# Autodesk Inventor assembly: Rotorschutz_Sandläufer
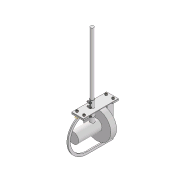
[picture p0: Inventor's stored thumbnail of the model, 180x180]
Saved by Autodesk Inventor 2020.1 (Build 241239000, 239)
## iProperties
Created: 2020-08-20
Part Number: Rotorschutz_Sandläufer
Document SubType Name: Assembly
Designer: s5chfeis
Author: s5chfeis
## Documents named in this file (11)
- Z:\Masterarbeit\CAD\CAD\Rotorschutz_Sandläufer.iam
- Z:\Masterarbeit\CAD\CAD\Motor_Dummy.ipt
- Z:\Masterarbeit\CAD\CAD\Rotorschutz_SL_BT2.ipt
- d:\Users\s5chfeis\Documents\Inventor\Content Center Files\R2020\de-DE\BS 4168(8)\BS 4168 - M10 x 30(7).ipt
- d:\Users\s5chfeis\Documents\Inventor\Content Center Files\R2020\de-DE\AS 1237 (2.1)\AS 1237 - 10.ipt
- d:\Users\s5chfeis\Documents\Inventor\Content Center Files\R2020\de-DE\AS 1112 (2)\AS 1112 - M10  Typ 8.ipt
- d:\Users\s5chfeis\Documents\Inventor\Content Center Files\R2020\de-DE\AS 1420\AS 1420 - 1973 - M8 x 25.ipt
- d:\Users\s5chfeis\Documents\Inventor\Content Center Files\R2020\de-DE\AS 1237 (2.1)\AS 1237 - 8.ipt
- d:\Users\s5chfeis\Documents\Inventor\Content Center Files\R2020\de-DE\AS 1112 (2)\AS 1112 - M8  Typ 8.ipt
- Z:\Masterarbeit\CAD\CAD\Huelse_2_komplett.iam
- Z:\Masterarbeit\CAD\CAD\Rotorschutz_Sandläufer_BG1.iam
## Components (33 placed, 10 different names)
1. Motor_Dummy:1 — Passend:1, Passend:2, Passend:3, Passend:6, Passend:38, Passend:40
2. Rotorschutz_SL_BT2:1 — Passend:6, Einfügen:1, Einfügen:2, Einfügen:3, Einfügen:4, Passend:39, Passend:41, Passend:42
3. BS 4168 : Teil 8 Senkkopf- und Halbrundschrauben mit Innensechskant - metrische Ausführung - Metrisch M10 x 30:1 — Passend:43
4. BS 4168 : Teil 8 Senkkopf- und Halbrundschrauben mit Innensechskant - metrische Ausführung - Metrisch M10 x 30:2
5. BS 4168 : Teil 8 Senkkopf- und Halbrundschrauben mit Innensechskant - metrische Ausführung - Metrisch M10 x 30:3 — Passend:16
6. BS 4168 : Teil 8 Senkkopf- und Halbrundschrauben mit Innensechskant - metrische Ausführung - Metrisch M10 x 30:4 — Passend:18
7. AS 1237 (2.1) 10:1 — Einfügen:1, Einfügen:6
8. AS 1237 (2.1) 10:2 — Einfügen:2, Einfügen:7
9. AS 1237 (2.1) 10:3 — Einfügen:3, Passend:19
10. AS 1237 (2.1) 10:4 — Einfügen:4, Passend:17
11. AS 1112 (2) - Metrisch M10  Typ 8:1 — Einfügen:6
12. AS 1112 (2) - Metrisch M10  Typ 8:2 — Einfügen:7
13. AS 1112 (2) - Metrisch M10  Typ 8:3 — Passend:16, Passend:17
14. AS 1112 (2) - Metrisch M10  Typ 8:4 — Passend:18, Passend:19
15. AS 1237 (2.1) 8:1 — Passend:31
16. AS 1237 (2.1) 8:3 — Passend:33
17. AS 1237 (2.1) 8:4 — Passend:35
18. AS 1237 (2.1) 8:5 — Passend:37
19. AS 1112 (2) - Metrisch M8  Typ 8:1 — Passend:31
20. AS 1112 (2) - Metrisch M8  Typ 8:2 — Passend:33
21. AS 1112 (2) - Metrisch M8  Typ 8:3 — Passend:35
22. AS 1112 (2) - Metrisch M8  Typ 8:4 — Passend:37
23. AS 1237 (2.1) 8:6 — Einfügen:8
24. AS 1237 (2.1) 8:7 — Einfügen:9
25. AS 1237 (2.1) 8:8 — Einfügen:10
26. AS 1237 (2.1) 8:9 — Einfügen:11
27. AS 1420 - Metrisch M8 x 25:1 — Einfügen:8
28. AS 1420 - Metrisch M8 x 25:2 — Einfügen:9
29. AS 1420 - Metrisch M8 x 25:3 — Einfügen:10
30. AS 1420 - Metrisch M8 x 25:4 — Einfügen:11
31. Huelse_2_komplett:1 [sub-assembly] — Passend:38, Passend:39
32. Huelse_2_komplett:2 [sub-assembly] — Passend:40, Passend:41
33. Rotorschutz_Sandläufer_BG1:1 [sub-assembly] — Passend:42, Passend:43
## Relationships (28: Mate 18, Insert 10)
- Passend:1 [Mate]: Motor_Dummy:1
- Passend:2 [Mate]: Motor_Dummy:1
- Passend:3 [Mate]: Motor_Dummy:1
- Passend:6 [Mate]: Motor_Dummy:1 ↔ Rotorschutz_SL_BT2:1
- Einfügen:1 [Insert]: Rotorschutz_SL_BT2:1 ↔ AS 1237 (2.1) 10:1
- Einfügen:2 [Insert]: Rotorschutz_SL_BT2:1 ↔ AS 1237 (2.1) 10:2
- Einfügen:3 [Insert]: Rotorschutz_SL_BT2:1 ↔ AS 1237 (2.1) 10:3
- Einfügen:4 [Insert]: Rotorschutz_SL_BT2:1 ↔ AS 1237 (2.1) 10:4
- Einfügen:6 [Insert]: AS 1237 (2.1) 10:1 ↔ AS 1112 (2) - Metrisch M10  Typ 8:1
- Einfügen:7 [Insert]: AS 1237 (2.1) 10:2 ↔ AS 1112 (2) - Metrisch M10  Typ 8:2
- Passend:16 [Mate]: BS 4168 : Teil 8 Senkkopf- und Halbrundschrauben mit Innensechskant - metrische Ausführung - Metrisch M10 x 30:3 ↔ AS 1112 (2) - Metrisch M10  Typ 8:3
- Passend:17 [Mate]: AS 1237 (2.1) 10:4 ↔ AS 1112 (2) - Metrisch M10  Typ 8:3
- Passend:18 [Mate]: BS 4168 : Teil 8 Senkkopf- und Halbrundschrauben mit Innensechskant - metrische Ausführung - Metrisch M10 x 30:4 ↔ AS 1112 (2) - Metrisch M10  Typ 8:4
- Passend:19 [Mate]: AS 1237 (2.1) 10:3 ↔ AS 1112 (2) - Metrisch M10  Typ 8:4
- Passend:31 [Mate]: AS 1237 (2.1) 8:1 ↔ AS 1112 (2) - Metrisch M8  Typ 8:1
- Passend:33 [Mate]: AS 1237 (2.1) 8:3 ↔ AS 1112 (2) - Metrisch M8  Typ 8:2
- Passend:35 [Mate]: AS 1237 (2.1) 8:4 ↔ AS 1112 (2) - Metrisch M8  Typ 8:3
- Passend:37 [Mate]: AS 1237 (2.1) 8:5 ↔ AS 1112 (2) - Metrisch M8  Typ 8:4
- Einfügen:8 [Insert]: AS 1237 (2.1) 8:6 ↔ AS 1420 - Metrisch M8 x 25:1
- Einfügen:9 [Insert]: AS 1237 (2.1) 8:7 ↔ AS 1420 - Metrisch M8 x 25:2
- Einfügen:10 [Insert]: AS 1237 (2.1) 8:8 ↔ AS 1420 - Metrisch M8 x 25:3
- Einfügen:11 [Insert]: AS 1237 (2.1) 8:9 ↔ AS 1420 - Metrisch M8 x 25:4
- Passend:38 [Mate]: Motor_Dummy:1 ↔ Huelse_2_komplett:1
- Passend:39 [Mate]: Rotorschutz_SL_BT2:1 ↔ Huelse_2_komplett:1
- Passend:40 [Mate]: Motor_Dummy:1 ↔ Huelse_2_komplett:2
- Passend:41 [Mate]: Rotorschutz_SL_BT2:1 ↔ Huelse_2_komplett:2
- Passend:42 [Mate]: Rotorschutz_SL_BT2:1 ↔ Rotorschutz_Sandläufer_BG1:1
- Passend:43 [Mate]: BS 4168 : Teil 8 Senkkopf- und Halbrundschrauben mit Innensechskant - metrische Ausführung - Metrisch M10 x 30:1 ↔ Rotorschutz_Sandläufer_BG1:1
